# Autodesk Inventor assembly: MM0948AN100_G60_001
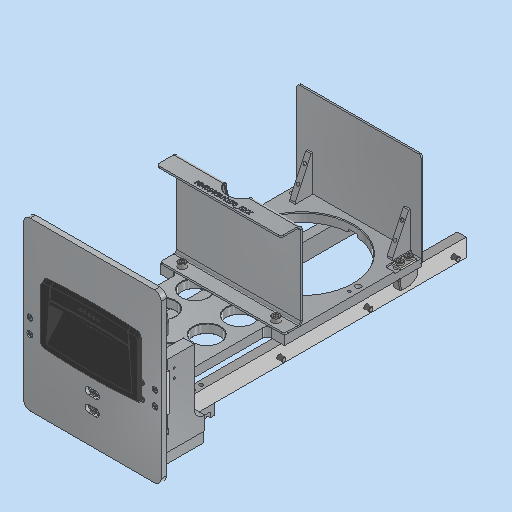
[picture p0: Inventor's stored thumbnail of the model, 512x512]
Saved by Autodesk Inventor 2023.3 (Build 273359000, 359)
## iProperties
RuleStatus: InUse
Created: 2023-03-28
Part Number: MM0948AN100_G60_001
Description: =<RBPARTNOTITLE2>
Document SubType Name: Assembly
Designer: FH/Wi
Mass: 2209.48 g
Surface Area: 3444.42 cm^2
Volume: 801.634 cm^3
Density: 2.75622 g/cm^3
AnP_Kategorie: 99
AnP_Material: =<Material>
AnP_TemplVers: 20200821
RBDOCUMENTTYPE: DRF
RBDOCUMENTVERSION: 00
RBDRAWINGMAINSCALE: 1:1
RBDRAWINGMISSINGSPEC: --
RBDRAWINGVOLUME: --
RBDSV1: 0850
RBGBEDGESIN1: +0,5
RBGBEDGESIN2: +0,2
RBGBEDGESOUT1: -0,3
RBGBEDGESOUT2: -0,1
RBMATERIAL: =<Material>
RBMATMEETS: --
RBMATNO: =<Part Number>
RBPARTMADEOF: --
RBPARTNO: SIEHE MNR
RBPARTNOTITLE1: Slide 285mm
RBPARTNOTITLE2: Schlitten 285mm
RBPARTSAFETYINDICATOR: --
RBSURFACE: --
RBSURFACE2: --
RBZEDGESNORM: ISO13715:2002-06
RBZGENDIMCLASS: m
RBZGENDIMNORM: ISO 2768-1:1989-11
RBZGENGEOCLASS: H
RBZGENGEONORM: ISO 2768-2:1989-11
RBZSURFACENORM: ISO13D2:2002-02
RBZTOLERANCENORM: ISO 14405-1:2010-12
Author: FH/Wi
Keywords: =<RBPARTMADEOF>
Comments: =<RBSURFACE2>
Revision Number: 01
## Documents named in this file (3)
- C:\Users\rea9an\Documents\Inventor\TCAI2412_te1910_EM\AS00000939.iam
- C:\Users\rea9an\Documents\Inventor\TCAI2412_te1910_EM\AS00000941.iam
- C:\Users\rea9an\Documents\Inventor\TCAI2412_te1910_EM\AS00000940.iam
## Components (2 placed, 2 different names)
1. AS00000940:1 [sub-assembly] — Fluchtend:2, Fluchtend:3
2. AS00000941:1 [sub-assembly] — Fluchtend:2, Fluchtend:3
## Relationships (3: Flush 2, Mate 1)
- [Mate] (10 mm): AS00000940:1 ↔ AS00000941:1
- Fluchtend:2 [Flush]: AS00000940:1 ↔ AS00000941:1
- Fluchtend:3 [Flush]: AS00000940:1 ↔ AS00000941:1
